# Autodesk Inventor assembly: FinalAssembly
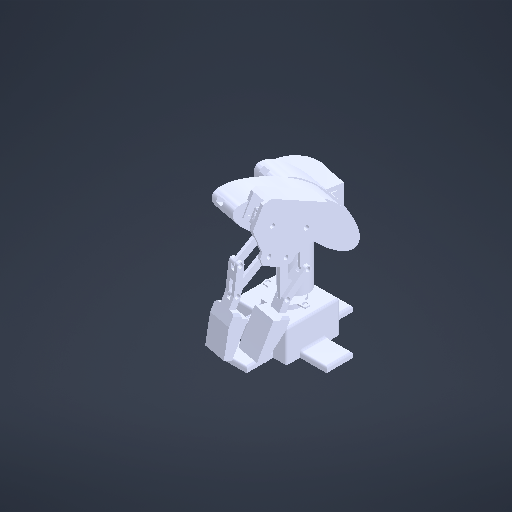
[picture p0: Inventor's stored thumbnail of the model, 512x512]
Saved by Autodesk Inventor 2026.1 (Build 301233020, 233B)
## iProperties
Created: 2026-09-25
Part Number: FinalAssembly
Document SubType Name: Assembly
Designer: nuzzo
Mass: 288.693 g
Surface Area: 1128.42 cm^2
Volume: 288.693 cm^3
Density: 1 g/cm^3
Author: nuzzo
## iProperties of the stored document Step Motor (28BYJ-48)_Varsayılan.ipt
Created: 2026-09-25
Part Number: Step Motor (28BYJ-48)_Varsayılan
Material: Generico
Document SubType Name: Modeling
Designer: nuzzo
Mass: 13.0783 g
Surface Area: 40.3008 cm^2
Volume: 13.0783 cm^3
Density: 1 g/cm^3
Appearance: Default
Author: nuzzo
Revision Number: TUTTO
## iProperties of the stored document lever.ipt.ipt
Created: 2026-09-25
Part Number: lever.ipt
Material: Generico
Document SubType Name: Modeling
Designer: nuzzo
Mass: 0.682276 g
Surface Area: 7.9401 cm^2
Volume: 0.682276 cm^3
Density: 1 g/cm^3
Appearance: Default
Author: nuzzo
Revision Number: TUTTO
## iProperties of the stored document gripper.stp.ipt
Created: 2026-09-25
Part Number: gripper.stp
Material: Generico
Document SubType Name: Modeling
Designer: nuzzo
Mass: 9.95625 g
Surface Area: 41.0793 cm^2
Volume: 9.95625 cm^3
Density: 1 g/cm^3
Appearance: Default
Author: nuzzo
Revision Number: TUTTO
## iProperties of the stored document Base.ipt
Created: 2026-09-25
Part Number: Base
Material: Generico
Document SubType Name: Modeling
Designer: nuzzo
Mass: 76.1833 g
Surface Area: 181.926 cm^2
Volume: 76.1833 cm^3
Density: 1 g/cm^3
Appearance: Default
Author: nuzzo
Revision Number: TUTTO
## iProperties of the stored document SG90 - Micro Servo 9g - Tower Pro.1_Peça.ipt
Created: 2026-09-25
Part Number: SG90 - Micro Servo 9g - Tower Pro.1_Peça
Material: Generico
Document SubType Name: Modeling
Designer: nuzzo
Mass: 7.04498 g
Surface Area: 49.3897 cm^2
Volume: 7.04498 cm^3
Density: 1 g/cm^3
Appearance: Default
Author: nuzzo
Revision Number: TUTTO
## iProperties of the stored document gear.stp.ipt
Created: 2026-09-25
Part Number: gear.stp
Material: Generico
Document SubType Name: Modeling
Designer: nuzzo
Mass: 2.33493 g
Surface Area: 21.6864 cm^2
Volume: 2.33493 cm^3
Density: 1 g/cm^3
Appearance: Default
Author: nuzzo
Revision Number: TUTTO
## iProperties of the stored document 360° Rotating arm v2.ipt.ipt
Created: 2026-09-25
Part Number: 360° Rotating arm v2.ipt
Material: Generico
Document SubType Name: Modeling
Designer: nuzzo
Mass: 68.1647 g
Surface Area: 139.809 cm^2
Volume: 68.1647 cm^3
Density: 1 g/cm^3
Appearance: Default
Author: nuzzo
Revision Number: TUTTO
## iProperties of the stored document First arm.ipt.ipt
Created: 2026-09-25
Part Number: First arm.ipt
Material: Generico
Document SubType Name: Modeling
Designer: nuzzo
Mass: 35.762 g
Surface Area: 187.219 cm^2
Volume: 35.762 cm^3
Density: 1 g/cm^3
Appearance: Default
Author: nuzzo
Revision Number: TUTTO
## iProperties of the stored document gear 2.1.stp.ipt
Created: 2026-09-25
Part Number: gear 2.1.stp
Material: Generico
Document SubType Name: Modeling
Designer: nuzzo
Mass: 2.20738 g
Surface Area: 22.2985 cm^2
Volume: 2.20738 cm^3
Density: 1 g/cm^3
Appearance: Default
Author: nuzzo
Revision Number: TUTTO
## iProperties of the stored document base 2.0 upload.stp.ipt
Created: 2026-09-25
Part Number: base 2.0 upload.stp
Material: Generico
Document SubType Name: Modeling
Designer: nuzzo
Mass: 12.6331 g
Surface Area: 97.9976 cm^2
Volume: 12.6331 cm^3
Density: 1 g/cm^3
Appearance: Default
Author: nuzzo
Revision Number: TUTTO
## iProperties of the stored document FinalRoboticArmModel.iam
Created: 2026-09-25
Part Number: FinalRoboticArmModel
Description: STEP AP214
Document SubType Name: Assembly
Designer: nuzzo
Mass: 288.693 g
Surface Area: 1128.42 cm^2
Volume: 288.693 cm^3
Density: 1 g/cm^3
Sending System: SolidWorks 2026
Preprocessor: SwSTEP 2.0
Title: FinalRoboticArmModel.STEP
Revision Number: TUTTO
## iProperties of the stored document SG90 - Micro Servo 9g - Tower Pro.2_Peça.ipt
Created: 2026-09-25
Part Number: SG90 - Micro Servo 9g - Tower Pro.2_Peça
Material: Generico
Document SubType Name: Modeling
Designer: nuzzo
Mass: 0.155429 g
Surface Area: 3.76055 cm^2
Volume: 0.155429 cm^3
Density: 1 g/cm^3
Appearance: Default
Author: nuzzo
Revision Number: TUTTO
## Documents named in this file (28)
- C:\Users\nuzzo\Desktop\4DOF Robotic Arm\FinalAssembly\FinalAssembly.iam
- **C:\Users\nuzzo\Desktop\4DOF Robotic Arm\FinalAssembly\FinalAssembly.iam*LocalDocs*xAaaaqucaAaaaaaaaAaaaqx2oOg*FinalRoboticArmModel.iam
- **C:\Users\nuzzo\Desktop\Braccio 4Dof\FinalAssembly.iam*LocalDocs*xAaaaaybaAaaaaaaaAaaaqi1uNa*Step Motor (28BYJ-48)_Varsayılan.ipt
- **C:\Users\nuzzo\Desktop\Braccio 4Dof\FinalAssembly.iam*LocalDocs*xAaaaapaaAaaaaaaaAaaaqlglGc*lever.ipt.ipt
- **C:\Users\nuzzo\Desktop\Braccio 4Dof\FinalAssembly.iam*LocalDocs*xAaaaaadaAaaaaaaaAaaaqeahNf*gripper.stp.ipt
- **C:\Users\nuzzo\Desktop\Braccio 4Dof\FinalAssembly.iam*LocalDocs*xAaaaasaaAaaaaaaaAaaaa2evMe*Base.ipt
- **C:\Users\nuzzo\Desktop\Braccio 4Dof\FinalAssembly.iam*LocalDocs*xAaaaqedaAaaaaaaaAaaaqpwaIc*SG90 - Micro Servo 9g - Tower Pro.1_Peça.ipt
- **C:\Users\nuzzo\Desktop\Braccio 4Dof\FinalAssembly.iam*LocalDocs*xAaaaqdaaAaaaaaaaAaaaai1gHb*gear.stp.ipt
- **C:\Users\nuzzo\Desktop\Braccio 4Dof\FinalAssembly.iam*LocalDocs*xAaaaqcbaAaaaaaaaAaaaqut2Xd*360° Rotating arm v2.ipt.ipt
- **C:\Users\nuzzo\Desktop\Braccio 4Dof\FinalAssembly.iam*LocalDocs*xAaaaqdaaAaaaaaaaAaaaqb350h*First arm.ipt.ipt
- **C:\Users\nuzzo\Desktop\Braccio 4Dof\FinalAssembly.iam*LocalDocs*xAaaaqgdaAaaaaaaaAaaaqe0xEa*gear 2.1.stp.ipt
- **C:\Users\nuzzo\Desktop\Braccio 4Dof\FinalAssembly.iam*LocalDocs*xAaaaqfaaAaaaaaaaAaaaa1su4c*base 2.0 upload.stp.ipt
- **C:\Users\nuzzo\Desktop\Braccio 4Dof\FinalAssembly.iam*LocalDocs*xAaaaqucaAaaaaaaaAaaaqx2oOg*FinalRoboticArmModel.iam
- **C:\Users\nuzzo\Desktop\Braccio 4Dof\FinalAssembly.iam*LocalDocs*xAaaaqwbaAaaaaaaaAaaaqf1tVd*SG90 - Micro Servo 9g - Tower Pro.2_Peça.ipt
- 360° Rotating arm v2.ipt
- First arm.ipt
- base 2.0 upload.stp
- gear.stp
- gear 2.1.stp
- lever.ipt
- gripper.stp
- C:\Users\nuzzo\Desktop\FinalRoboticArmModel.STEP
- C:\Users\nuzzo\Desktop\Braccio 4Dof\FinalAssembly\AIP\FEA\fk7wsfeu8.fins
- C:\Users\nuzzo\Desktop\Braccio 4Dof\FinalAssembly\AIP\FEA\fk7wsfeu8.fsat
- C:\Users\nuzzo\Desktop\Braccio 4Dof\FinalAssembly\AIP\FEA\fk7wsfeu8.ftes
- C:\Users\nuzzo\Desktop\Braccio 4Dof\FinalAssembly\AIP\FEA\fk7wsfeu8.fwiz
- C:\Users\nuzzo\Desktop\Braccio 4Dof\FinalAssembly\AIP\FEA\fk7wsff40.fmsh
- C:\Users\nuzzo\Desktop\Braccio 4Dof\FinalAssembly\AIP\FEA\fk7wsff41.fres
## Components (1 placed, 1 different names)
1. FinalRoboticArmModel:1 [sub-assembly]
## Named parameters: sa_0 = 0, sa_1 = -500, sa_2 = 0
note: some values were not read from the file. Shown as the stored number, unit unknown: "sa_0", "sa_1", "sa_2".
